# Autodesk Inventor assembly: MM0937AN100_G15_004
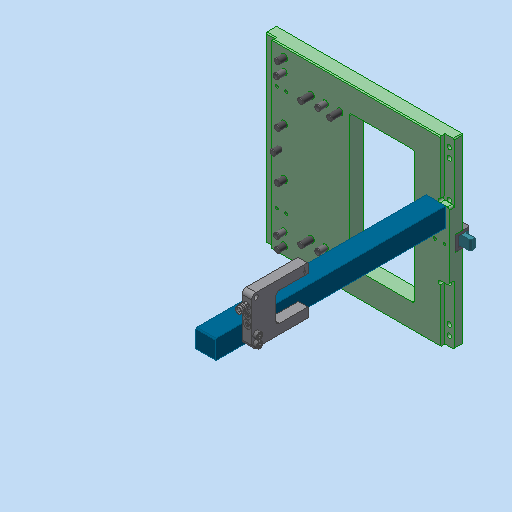
[picture p0: Inventor's stored thumbnail of the model, 512x512]
Saved by Autodesk Inventor 2023.3 (Build 273359000, 359)
## iProperties
Created: 2018-10-29
Part Number: MM0937AN100_G15_004
Document SubType Name: Assembly
Designer: Rose
Mass: 3418.22 g
Surface Area: 1317.58 cm^2
Volume: 514.524 cm^3
Density: 6.64347 g/cm^3
AnP_Kommentar_aktuell: =<Comments>
AnP_Material_aktuell: =<Material>
Author: Rose
Revision Number: 01
## Documents named in this file (10)
- C:\Users\rea9an\Documents\Inventor\TCAI2412_te1910_EM\AS00000910.iam
- C:\Users\rea9an\Documents\Inventor\TCAI2412_te1910_EM\PT00004887.ipt
- C:\Users\rea9an\Documents\Inventor\TCAI2412_te1910_EM\AS00000890.iam
- C:\Users\rea9an\Documents\Inventor\TCAI2412_te1910_EM\PT00004923.ipt
- C:\Users\rea9an\Documents\Inventor\TCAI2412_te1910_EM\PT00004888.ipt
- C:\Users\rea9an\Documents\Inventor\TCAI2412_te1910_EM\PT00004358.ipt
- C:\Users\rea9an\Documents\Inventor\TCAI2412_te1910_EM\PT00004869.ipt
- C:\Users\rea9an\Documents\Inventor\TCAI2412_te1910_EM\PT00004880.ipt
- C:\Users\rea9an\Documents\Inventor\TCAI2412_te1910_EM\PT00004546.ipt
- C:\Users\rea9an\Documents\Inventor\TCAI2412_te1910_EM\PT00004549.ipt
## Components (23 placed, 9 different names)
1. PT00004549:1 — Einfügen:1, Einfügen:2, Einfügen:3, Einfügen:4, Einfügen:5, Einfügen:6, Einfügen:23, Einfügen:24, Einfügen:31, Einfügen:32, Einfügen:33, Einfügen:34, Einfügen:35, Einfügen:36
2. AS00000890:1 [sub-assembly] — Einfügen:1, Einfügen:5
3. AS00000890:2 [sub-assembly] — Einfügen:2, Einfügen:4
4. AS00000890:3 [sub-assembly] — Einfügen:3, Einfügen:6
5. PT00004888:1
6. PT00004888:2
7. PT00004888:3
8. PT00004888:4
9. PT00004887:7 — Einfügen:31
10. PT00004887:8
11. PT00004887:10 — Einfügen:34
12. PT00004923:1
13. PT00004923:2
14. PT00004923:3 — Einfügen:36
15. PT00004923:4 — Einfügen:35
16. PT00004546:1 — Einfügen:23, Einfügen:24, Einfügen:25, Einfügen:26
17. PT00004358:1 — Einfügen:25, Einfügen:26, Einfügen:27, Einfügen:28
18. PT00004869:1 — Einfügen:27
19. PT00004869:2 — Einfügen:28
20. PT00004880:1
21. PT00004880:2
22. PT00004887:11 — Einfügen:32
23. PT00004887:12 — Einfügen:33
## Relationships (26: Insert 26)
- Einfügen:1 [Insert]: PT00004549:1 ↔ AS00000890:1
- Einfügen:2 [Insert]: PT00004549:1 ↔ AS00000890:2
- Einfügen:3 [Insert]: PT00004549:1 ↔ AS00000890:3
- Einfügen:4 [Insert]: PT00004549:1 ↔ AS00000890:2
- Einfügen:5 [Insert]: PT00004549:1 ↔ AS00000890:1
- Einfügen:6 [Insert]: PT00004549:1 ↔ AS00000890:3
- [Insert]: PT00004549:1 ↔ PT00004888:1
- [Insert]: PT00004549:1 ↔ PT00004888:2
- [Insert]: PT00004549:1 ↔ PT00004888:3
- [Insert]: PT00004549:1 ↔ PT00004888:4
- [Insert]: PT00004549:1 ↔ PT00004923:1
- [Insert]: PT00004549:1 ↔ PT00004923:2
- Einfügen:23 [Insert]: PT00004549:1 ↔ PT00004546:1
- Einfügen:24 [Insert]: PT00004549:1 ↔ PT00004546:1
- Einfügen:25 [Insert]: PT00004546:1 ↔ PT00004358:1
- Einfügen:26 [Insert]: PT00004546:1 ↔ PT00004358:1
- Einfügen:27 [Insert]: PT00004358:1 ↔ PT00004869:1
- Einfügen:28 [Insert]: PT00004358:1 ↔ PT00004869:2
- [Insert]: PT00004549:1 ↔ PT00004880:1
- [Insert]: PT00004549:1 ↔ PT00004880:2
- Einfügen:31 [Insert]: PT00004549:1 ↔ PT00004887:7
- Einfügen:32 [Insert]: PT00004549:1 ↔ PT00004887:11
- Einfügen:33 [Insert]: PT00004549:1 ↔ PT00004887:12
- Einfügen:34 [Insert]: PT00004549:1 ↔ PT00004887:10
- Einfügen:35 [Insert]: PT00004549:1 ↔ PT00004923:4
- Einfügen:36 [Insert]: PT00004549:1 ↔ PT00004923:3
